# Autodesk Inventor assembly: SKU01900 - BisagraCanber60mmX33mm
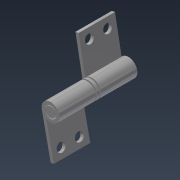
[picture p0: Inventor's stored thumbnail of the model, 180x180]
Saved by Autodesk Inventor 2021.2 (Build 252289000, 289)
## iProperties
Created: 2026-08-14
Part Number: SKU01900 - BisagraCanber60mmX33mm
Document SubType Name: Assembly
Designer: nelso
Author: nelso
## Documents named in this file (4)
- C:\Users\Tecnica\OneDrive\Documentos\Mecanica\Soporte-Paciente-Espinografia\Workspace\SKU01900 - BisagraCanber60mmX33mm.iam
- C:\Users\Tecnica\OneDrive\Documentos\Mecanica\Soporte-Paciente-Espinografia\Workspace\part2bisagra.ipt
- C:\Users\Tecnica\OneDrive\Documentos\Mecanica\Soporte-Paciente-Espinografia\Workspace\part3bisagra.ipt
- C:\Users\Tecnica\OneDrive\Documentos\Mecanica\Soporte-Paciente-Espinografia\Workspace\part1bisagra.ipt
## Components (3 placed, 3 different names)
1. SP29V1 Bisagra P1:2 — Mate:2, Mate:4
2. SP29V1 Bisagra P1_MIR:1 — Mate:1, Mate:3
3. SP30V1 Bisagra P2:1 — Mate:1, Mate:2, Mate:3, Mate:4
## Relationships (4: Mate 4)
- Mate:1: SP29V1 Bisagra P1_MIR:1 ↔ SP30V1 Bisagra P2:1
- Mate:2: SP29V1 Bisagra P1:2 ↔ SP30V1 Bisagra P2:1
- Mate:3 (1 mm): SP29V1 Bisagra P1_MIR:1 ↔ SP30V1 Bisagra P2:1
- Mate:4 (1 mm): SP29V1 Bisagra P1:2 ↔ SP30V1 Bisagra P2:1
